# Autodesk Inventor assembly: Zusammenbau
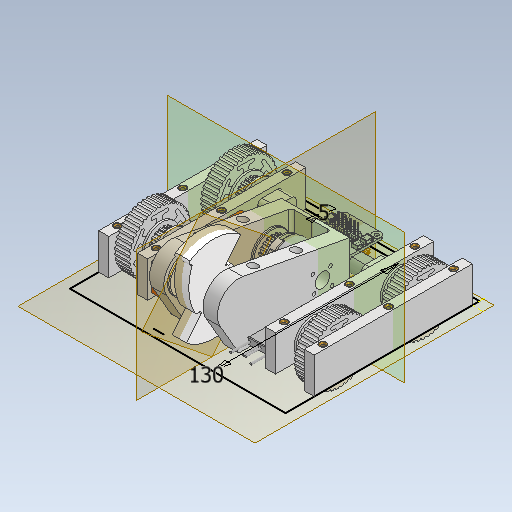
[picture p0: Inventor's stored thumbnail of the model, 512x512]
Saved by Autodesk Inventor 2026.4 (Build 304435030, 435C)
## iProperties
Created: 2026-11-20
Part Number: Zusammenbau
Document SubType Name: Assembly
Designer: weira
Author: weira
## Documents named in this file (6)
- C:\Users\weira\OneDrive\Desktop\Battlebot Projekt\Battle-Bot-Project\Version2\Zusammenbau.iam
- C:\Users\weira\OneDrive\Desktop\Battlebot Projekt\Battle-Bot-Project\Version2\drive_assembly\drive assembly_links.iam
- C:\Users\weira\OneDrive\Desktop\Battlebot Projekt\Battle-Bot-Project\Version2\Kaufteile\Tattu 2S 550mAh.ipt
- C:\Users\weira\OneDrive\Desktop\Battlebot Projekt\Battle-Bot-Project\Version2\weapon_assembly\weapon assembly.iam
- C:\Users\weira\OneDrive\Desktop\Battlebot Projekt\Battle-Bot-Project\Version2\Kaufteile\Cyber_Brick_Receiver.ipt
- C:\Users\weira\OneDrive\Desktop\Battlebot Projekt\Battle-Bot-Project\Version2\Kaufteile\Hobbywing_10A_ESC.ipt
## Components (6 placed, 5 different names)
1. drive assembly_links:1 [sub-assembly] — Passend:1, Passend:2, Passend:3, Fluchtend:3, Passend:11
2. drive assembly_links:2 [sub-assembly] — Fluchtend:1, Passend:4, Passend:5
3. weapon assembly:1 [sub-assembly] — Passend:6, Passend:7, Passend:11
4. Tattu 2S 550mAh:1
5. Hobbywing_10A_ESC:1
6. Cyber_Brick_Receiver:2 — Passend:10, Fluchtend:3, Fluchtend:4
## Relationships (12: Mate 9, Flush 3)
- Passend:1 [Mate] (-75 mm): drive assembly_links:1
- Passend:2 [Mate]: drive assembly_links:1
- Passend:3 [Mate]: drive assembly_links:1
- Fluchtend:1 [Flush] (-75 mm): drive assembly_links:2
- Passend:4 [Mate]: drive assembly_links:2
- Passend:5 [Mate]: drive assembly_links:2
- Passend:6 [Mate]: weapon assembly:1
- Passend:7 [Mate] (-5 mm): weapon assembly:1
- Passend:10 [Mate]: Cyber_Brick_Receiver:2
- Fluchtend:3 [Flush]: drive assembly_links:1 ↔ Cyber_Brick_Receiver:2
- Fluchtend:4 [Flush] (14.5 mm): Cyber_Brick_Receiver:2
- Passend:11 [Mate]: drive assembly_links:1 ↔ weapon assembly:1
